# Autodesk Inventor assembly: RDS-500-0000 Reagent Dosing Station
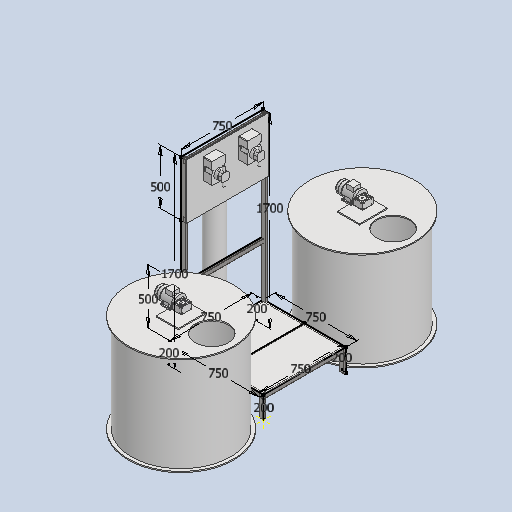
[picture p0: Inventor's stored thumbnail of the model, 512x512]
Saved by Autodesk Inventor 2026.2 (Build 302298000, 298)
## iProperties
Created: 2026-10-27
Part Number: RDS-500-0000 Reagent Dosing Station
Document SubType Name: Assembly
Designer: user
Author: user
## Documents named in this file (8)
- C:\Users\admin\Documents\Inventor\PRF-Parfino\RDS-500 Reagent Dosing Station\RDS-500-0000 Reagent Dosing Station.iam
- C:\Users\admin\Documents\Inventor\PRF-Parfino\RDS-500 Reagent Dosing Station\RDS-500-1000 Frame.iam
- C:\Users\admin\Documents\Inventor\PRF-Parfino\RDS-GHN500 Reagent Dosing Station\RDS-GHN500-2000 Tank.ipt
- C:\Users\admin\Documents\Inventor\PRF-Parfino\RDS-GHN500 Reagent Dosing Station\RDS-GHN500-2000 Tank1.ipt
- C:\Users\admin\Documents\Inventor\PRF-Parfino\RDS1\Purchased\RDS-5004 Receiver.ipt
- C:\Users\admin\Documents\Inventor\PRF-Parfino\Старые модели\СДР 033 Электроклапан 3х ходовой.ipt
- C:\Users\admin\Documents\Inventor\PRF-Parfino\Старые модели\СДР 030 Дозатор реагента .ipt
- C:\Users\admin\Documents\Inventor\PRF-Parfino\Старые модели\СДР 060 Мотор-редуктор 2.0.ipt
## Components (9 placed, 7 different names)
1. RDS-500-1000 Frame:1 [sub-assembly] — Flush:1, Angle:1, Tangent:1, Tangent:2, Flush:2, Tangent:3, Tangent:4, Angle:2, Flush:3, Tangent:5, Angle:3, Mate:1, Flush:4, Flush:5, Mate:2, Flush:6, Flush:7
2. RDS-GHN500-2000 Tank:1 — Flush:1, Angle:1, Tangent:1, Tangent:2, Rotational:1
3. RDS-GHN500-2000 Tank1:1 — Flush:2, Tangent:3, Tangent:4, Rotational:2
4. RDS-5004 Receiver:1 — Angle:2, Flush:3, Tangent:5
5. СДР 033 Электроклапан 3х ходовой:1 — Angle:3
6. СДР 030 Дозатор реагента :1 — Mate:1, Flush:4, Flush:5
7. СДР 030 Дозатор реагента :2 — Mate:2, Flush:6, Flush:7
8. СДР 060 Мотор-редуктор 2.0:1 — Rotational:1
9. СДР 060 Мотор-редуктор 2.0:2 — Rotational:2
## Relationships (19: Flush 7, Tangent 5, Angle 3, Mate 2, RevoluteJoint 2)
- Flush:1: RDS-500-1000 Frame:1 ↔ RDS-GHN500-2000 Tank:1
- Angle:1 (180 deg): RDS-500-1000 Frame:1 ↔ RDS-GHN500-2000 Tank:1
- Tangent:1: RDS-500-1000 Frame:1 ↔ RDS-GHN500-2000 Tank:1
- Tangent:2: RDS-500-1000 Frame:1 ↔ RDS-GHN500-2000 Tank:1
- Flush:2: RDS-500-1000 Frame:1 ↔ RDS-GHN500-2000 Tank1:1
- Tangent:3: RDS-500-1000 Frame:1 ↔ RDS-GHN500-2000 Tank1:1
- Tangent:4: RDS-500-1000 Frame:1 ↔ RDS-GHN500-2000 Tank1:1
- Angle:2 (0 deg): RDS-500-1000 Frame:1 ↔ RDS-5004 Receiver:1
- Flush:3: RDS-500-1000 Frame:1 ↔ RDS-5004 Receiver:1
- Tangent:5: RDS-500-1000 Frame:1 ↔ RDS-5004 Receiver:1
- Angle:3 (0 deg): RDS-500-1000 Frame:1 ↔ СДР 033 Электроклапан 3х ходовой:1
- Mate:1: RDS-500-1000 Frame:1 ↔ СДР 030 Дозатор реагента :1
- Flush:4 (50 mm): RDS-500-1000 Frame:1 ↔ СДР 030 Дозатор реагента :1
- Flush:5 (-150 mm): RDS-500-1000 Frame:1 ↔ СДР 030 Дозатор реагента :1
- Mate:2: RDS-500-1000 Frame:1 ↔ СДР 030 Дозатор реагента :2
- Flush:6 (50 mm): RDS-500-1000 Frame:1 ↔ СДР 030 Дозатор реагента :2
- Flush:7 (150 mm): RDS-500-1000 Frame:1 ↔ СДР 030 Дозатор реагента :2
- Rotational:1 [RevoluteJoint] (30 mm): RDS-GHN500-2000 Tank:1 ↔ СДР 060 Мотор-редуктор 2.0:1
- Rotational:2 [RevoluteJoint] (30 mm): RDS-GHN500-2000 Tank1:1 ↔ СДР 060 Мотор-редуктор 2.0:2
